# Autodesk Inventor assembly: JGA25-370_12V_170RPM
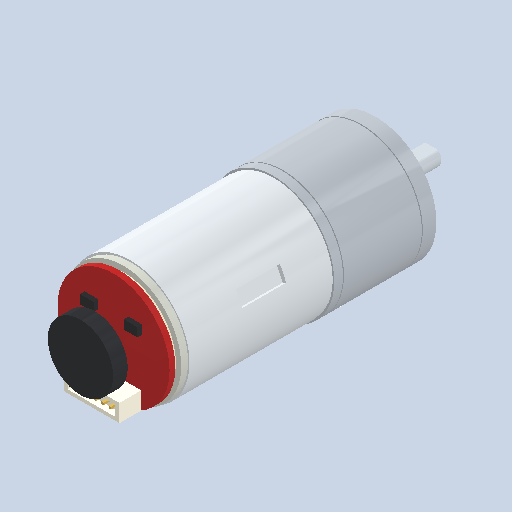
[picture p0: Inventor's stored thumbnail of the model, 512x512]
Saved by Autodesk Inventor 2025.3 (Build 293356000, 356)
## iProperties
Company: Open CASCADE
Created: 2026-11-27
Part Number: JGA25-370_12V_170RPM
Description: Open CASCADE Model
Document SubType Name: Assembly
Designer: STEVEN LONDOÑO
Authority: Unknown
Sending System: Open CASCADE 7.9
Preprocessor: Open CASCADE STEP processor 7.9
Title: Open CASCADE Shape Model
Author: Author
## Documents named in this file (20)
- C:\Users\STEVEN LONDOÑO\Documents\BANDA TRANSPORTADORA TERMINADA\BANDA TRANSPORTADORA VALIDACION MECANICA V2\Motorreductor.iam
- C:\Users\STEVEN LONDOÑO\Documents\BANDA TRANSPORTADORA TERMINADA\BANDA TRANSPORTADORA VALIDACION MECANICA V2\Reductora.ipt
- C:\Users\STEVEN LONDOÑO\Documents\BANDA TRANSPORTADORA TERMINADA\BANDA TRANSPORTADORA VALIDACION MECANICA V2\Motor_DC.ipt
- C:\Users\STEVEN LONDOÑO\Documents\BANDA TRANSPORTADORA TERMINADA\BANDA TRANSPORTADORA VALIDACION MECANICA V2\Tapa.ipt
- C:\Users\STEVEN LONDOÑO\Documents\BANDA TRANSPORTADORA TERMINADA\BANDA TRANSPORTADORA VALIDACION MECANICA V2\Separador.ipt
- C:\Users\STEVEN LONDOÑO\Documents\BANDA TRANSPORTADORA TERMINADA\BANDA TRANSPORTADORA VALIDACION MECANICA V2\PCB_encoder.ipt
- C:\Users\STEVEN LONDOÑO\Documents\BANDA TRANSPORTADORA TERMINADA\BANDA TRANSPORTADORA VALIDACION MECANICA V2\Conector_6_pines.ipt
- C:\Users\STEVEN LONDOÑO\Documents\BANDA TRANSPORTADORA TERMINADA\BANDA TRANSPORTADORA VALIDACION MECANICA V2\Eje_encoder.ipt
- C:\Users\STEVEN LONDOÑO\Documents\BANDA TRANSPORTADORA TERMINADA\BANDA TRANSPORTADORA VALIDACION MECANICA V2\Disco_magnetico.ipt
- C:\Users\STEVEN LONDOÑO\Documents\BANDA TRANSPORTADORA TERMINADA\BANDA TRANSPORTADORA VALIDACION MECANICA V2\Sensor_Hall_1.ipt
- C:\Users\STEVEN LONDOÑO\Documents\BANDA TRANSPORTADORA TERMINADA\BANDA TRANSPORTADORA VALIDACION MECANICA V2\Sensor_Hall_2.ipt
- C:\Users\STEVEN LONDOÑO\Documents\BANDA TRANSPORTADORA TERMINADA\BANDA TRANSPORTADORA VALIDACION MECANICA V2\Pin_1.ipt
- C:\Users\STEVEN LONDOÑO\Documents\BANDA TRANSPORTADORA TERMINADA\BANDA TRANSPORTADORA VALIDACION MECANICA V2\Pin_2.ipt
- C:\Users\STEVEN LONDOÑO\Documents\BANDA TRANSPORTADORA TERMINADA\BANDA TRANSPORTADORA VALIDACION MECANICA V2\Pin_3.ipt
- C:\Users\STEVEN LONDOÑO\Documents\BANDA TRANSPORTADORA TERMINADA\BANDA TRANSPORTADORA VALIDACION MECANICA V2\Pin_4.ipt
- C:\Users\STEVEN LONDOÑO\Documents\BANDA TRANSPORTADORA TERMINADA\BANDA TRANSPORTADORA VALIDACION MECANICA V2\Pin_5.ipt
- C:\Users\STEVEN LONDOÑO\Documents\BANDA TRANSPORTADORA TERMINADA\BANDA TRANSPORTADORA VALIDACION MECANICA V2\Pin_6.ipt
- C:\Users\STEVEN LONDOÑO\Documents\BANDA TRANSPORTADORA TERMINADA\BANDA TRANSPORTADORA VALIDACION MECANICA V2\Tornillo_1.ipt
- C:\Users\STEVEN LONDOÑO\Documents\BANDA TRANSPORTADORA TERMINADA\BANDA TRANSPORTADORA VALIDACION MECANICA V2\Tornillo_2.ipt
- C:\Users\STEVEN LONDOÑO\Documents\BANDA TRANSPORTADORA TERMINADA\BANDA TRANSPORTADORA VALIDACION MECANICA V2\Eje_salida_D4.ipt
## Components (19 placed, 19 different names)
1. Reductora_1 — Giro_salida_JGA
2. Motor_DC_2 — Montaje_Motor_DC_2_1, Montaje_Motor_DC_2_2, Montaje_Motor_DC_2_3
3. Tapa_3 — Montaje_Tapa_3_1, Montaje_Tapa_3_2, Montaje_Tapa_3_3, Giro_eje_encoder
4. Separador_4 — Montaje_Separador_4_1, Montaje_Separador_4_2, Montaje_Separador_4_3
5. PCB_encoder_5 — Montaje_PCB_encoder_5_1, Montaje_PCB_encoder_5_2, Montaje_PCB_encoder_5_3
6. Conector_6_pines_6 — Montaje_Conector_6_pines_6_1, Montaje_Conector_6_pines_6_2, Montaje_Conector_6_pines_6_3
7. Eje_encoder_7 — Giro_eje_encoder, Disco_sobre_encoder_1, Disco_sobre_encoder_2, Disco_sobre_encoder_3
8. Disco_magnetico_8 — Disco_sobre_encoder_1, Disco_sobre_encoder_2, Disco_sobre_encoder_3
9. Sensor_Hall_1_9 — Montaje_Sensor_Hall_1_9_1, Montaje_Sensor_Hall_1_9_2, Montaje_Sensor_Hall_1_9_3
10. Sensor_Hall_2_10 — Montaje_Sensor_Hall_2_10_1, Montaje_Sensor_Hall_2_10_2, Montaje_Sensor_Hall_2_10_3
11. Pin_1_11 — Montaje_Pin_1_11_1, Montaje_Pin_1_11_2, Montaje_Pin_1_11_3
12. Pin_2_12 — Montaje_Pin_2_12_1, Montaje_Pin_2_12_2, Montaje_Pin_2_12_3
13. Pin_3_13 — Montaje_Pin_3_13_1, Montaje_Pin_3_13_2, Montaje_Pin_3_13_3
14. Pin_4_14 — Montaje_Pin_4_14_1, Montaje_Pin_4_14_2, Montaje_Pin_4_14_3
15. Pin_5_15 — Montaje_Pin_5_15_1, Montaje_Pin_5_15_2, Montaje_Pin_5_15_3
16. Pin_6_16 — Montaje_Pin_6_16_1, Montaje_Pin_6_16_2, Montaje_Pin_6_16_3
17. Tornillo_1_17 — Montaje_Tornillo_1_17_1, Montaje_Tornillo_1_17_2, Montaje_Tornillo_1_17_3
18. Tornillo_2_18 — Montaje_Tornillo_2_18_1, Montaje_Tornillo_2_18_2, Montaje_Tornillo_2_18_3
19. Eje_salida_D4_19 — Giro_salida_JGA
## Relationships (50: Flush 48, RevoluteJoint 2)
- Montaje_Motor_DC_2_1 [Flush]: Motor_DC_2
- Montaje_Motor_DC_2_2 [Flush]: Motor_DC_2
- Montaje_Motor_DC_2_3 [Flush]: Motor_DC_2
- Montaje_Tapa_3_1 [Flush]: Tapa_3
- Montaje_Tapa_3_2 [Flush]: Tapa_3
- Montaje_Tapa_3_3 [Flush]: Tapa_3
- Montaje_Separador_4_1 [Flush]: Separador_4
- Montaje_Separador_4_2 [Flush]: Separador_4
- Montaje_Separador_4_3 [Flush]: Separador_4
- Montaje_PCB_encoder_5_1 [Flush]: PCB_encoder_5
- Montaje_PCB_encoder_5_2 [Flush]: PCB_encoder_5
- Montaje_PCB_encoder_5_3 [Flush]: PCB_encoder_5
- Montaje_Conector_6_pines_6_1 [Flush]: Conector_6_pines_6
- Montaje_Conector_6_pines_6_2 [Flush]: Conector_6_pines_6
- Montaje_Conector_6_pines_6_3 [Flush]: Conector_6_pines_6
- Montaje_Sensor_Hall_1_9_1 [Flush]: Sensor_Hall_1_9
- Montaje_Sensor_Hall_1_9_2 [Flush]: Sensor_Hall_1_9
- Montaje_Sensor_Hall_1_9_3 [Flush]: Sensor_Hall_1_9
- Montaje_Sensor_Hall_2_10_1 [Flush]: Sensor_Hall_2_10
- Montaje_Sensor_Hall_2_10_2 [Flush]: Sensor_Hall_2_10
- Montaje_Sensor_Hall_2_10_3 [Flush]: Sensor_Hall_2_10
- Montaje_Pin_1_11_1 [Flush]: Pin_1_11
- Montaje_Pin_1_11_2 [Flush]: Pin_1_11
- Montaje_Pin_1_11_3 [Flush]: Pin_1_11
- Montaje_Pin_2_12_1 [Flush]: Pin_2_12
- Montaje_Pin_2_12_2 [Flush]: Pin_2_12
- Montaje_Pin_2_12_3 [Flush]: Pin_2_12
- Montaje_Pin_3_13_1 [Flush]: Pin_3_13
- Montaje_Pin_3_13_2 [Flush]: Pin_3_13
- Montaje_Pin_3_13_3 [Flush]: Pin_3_13
- Montaje_Pin_4_14_1 [Flush]: Pin_4_14
- Montaje_Pin_4_14_2 [Flush]: Pin_4_14
- Montaje_Pin_4_14_3 [Flush]: Pin_4_14
- Montaje_Pin_5_15_1 [Flush]: Pin_5_15
- Montaje_Pin_5_15_2 [Flush]: Pin_5_15
- Montaje_Pin_5_15_3 [Flush]: Pin_5_15
- Montaje_Pin_6_16_1 [Flush]: Pin_6_16
- Montaje_Pin_6_16_2 [Flush]: Pin_6_16
- Montaje_Pin_6_16_3 [Flush]: Pin_6_16
- Montaje_Tornillo_1_17_1 [Flush]: Tornillo_1_17
- Montaje_Tornillo_1_17_2 [Flush]: Tornillo_1_17
- Montaje_Tornillo_1_17_3 [Flush]: Tornillo_1_17
- Montaje_Tornillo_2_18_1 [Flush]: Tornillo_2_18
- Montaje_Tornillo_2_18_2 [Flush]: Tornillo_2_18
- Montaje_Tornillo_2_18_3 [Flush]: Tornillo_2_18
- Giro_salida_JGA [RevoluteJoint] (-0.5 mm): Reductora_1 ↔ Eje_salida_D4_19
- Giro_eje_encoder [RevoluteJoint]: Tapa_3 ↔ Eje_encoder_7
- Disco_sobre_encoder_1 [Flush]: Eje_encoder_7 ↔ Disco_magnetico_8
- Disco_sobre_encoder_2 [Flush]: Eje_encoder_7 ↔ Disco_magnetico_8
- Disco_sobre_encoder_3 [Flush]: Eje_encoder_7 ↔ Disco_magnetico_8
